# Autodesk Inventor assembly: Receiver_Assembly.ipt
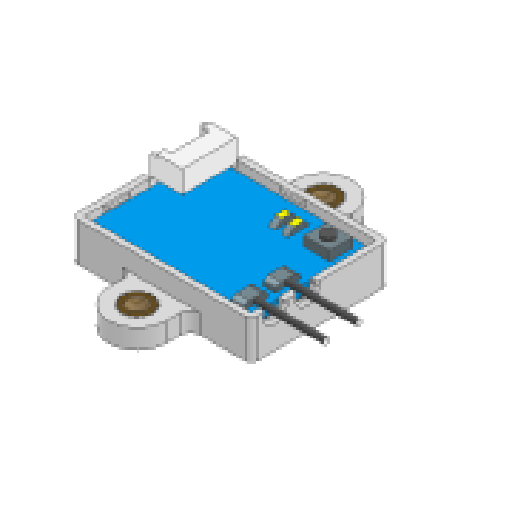
[picture p0: Inventor's stored thumbnail of the model, 512x512]
Saved by Autodesk Inventor 2025 (Build 290162000, 162)
## iProperties
Created: 2024-11-14
Part Number: Receiver_Assembly.ipt
Document SubType Name: Assembly
Designer: OSB
Mass: 8 g
Surface Area: 41.0039 cm^2
Volume: 3.12033 cm^3
Sending System: Autodesk Inventor 2021
Preprocessor: unknown
Minimum Resolution: 0.01
Sent Units: Millimeter
Translation Standard: IGES 5.3
Model Creation Time: 2020-07-07
Title: S500 Frame
Author: OSB
## Documents named in this file (4)
- C:\Users\OSB\Desktop\SB\1.Projects\캡스톤 디자인(2)_Paper\Modeling\Implementation_Design\Ver_004_mass_update\Receiver_Assembly.ipt.iam
- C:\Users\OSB\Desktop\SB\1.Projects\캡스톤 디자인(2)_Paper\Modeling\Implementation_Design\Ver_004_mass_update\Receiver_FrSky_XSR.ipt
- C:\Users\OSB\Desktop\SB\1.Projects\캡스톤 디자인(2)_Paper\Modeling\Implementation_Design\Ver_004_mass_update\Receiver_Housing.ipt
- C:\Users\OSB\Desktop\SB\1.Projects\캡스톤 디자인(2)_Paper\Modeling\Implementation_Design\Ver_004_mass_update\InsertNut_M3.ipt
## Components (4 placed, 3 different names)
1. Receiver_FrSky_XSR:1 — 메이트:1, 메이트:2, 메이트:3
2. Receiver_Housing:1 — 메이트:1, 메이트:2, 메이트:3, 강체:1, 강체:2
3. InsertNut_M3:1 — 강체:1
4. InsertNut_M3:2 — 강체:2
## Relationships (5: Mate 3, WeldJoint 2)
- 메이트:1 [Mate]: Receiver_FrSky_XSR:1 ↔ Receiver_Housing:1
- 메이트:2 [Mate] (0.5 mm): Receiver_FrSky_XSR:1 ↔ Receiver_Housing:1
- 메이트:3 [Mate] (0.75 mm): Receiver_FrSky_XSR:1 ↔ Receiver_Housing:1
- 강체:1 [WeldJoint]: Receiver_Housing:1 ↔ InsertNut_M3:1
- 강체:2 [WeldJoint]: Receiver_Housing:1 ↔ InsertNut_M3:2
